# Autodesk Inventor assembly: eth32v1
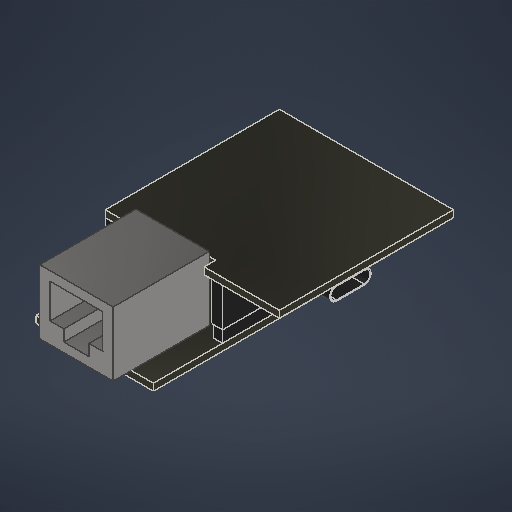
[picture p0: Inventor's stored thumbnail of the model, 512x512]
Saved by Autodesk Inventor 2027.1 (Build 311270010, 270A)
## iProperties
Created: 2026-09-27
Part Number: eth32v1
Document SubType Name: Assembly
Designer: work
Author: work
## Documents named in this file (3)
- C:\Users\work\Desktop\Mini WebServer\모델링\ETH32_v1\eth32v1.iam
- C:\Users\work\Desktop\Mini WebServer\모델링\ETH32_v1\ETH32 uploader.ipt
- C:\Users\work\Desktop\Mini WebServer\모델링\ETH32_v1\ETH32.ipt
## Components (2 placed, 2 different names)
1. ETH32 uploader:1 — 메이트:1, 플러쉬:1, 플러쉬:2
2. ETH32:1 — 메이트:1, 플러쉬:1, 플러쉬:2
## Relationships (3: Flush 2, Mate 1)
- 메이트:1 [Mate]: ETH32 uploader:1 ↔ ETH32:1
- 플러쉬:1 [Flush]: ETH32 uploader:1 ↔ ETH32:1
- 플러쉬:2 [Flush]: ETH32 uploader:1 ↔ ETH32:1
